# Autodesk Inventor assembly: BG_Gesammt
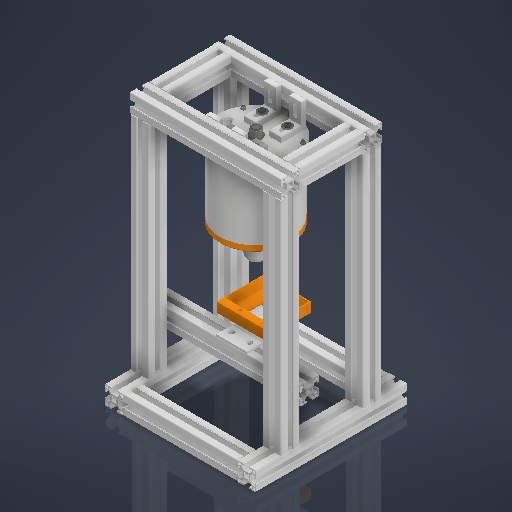
[picture p0: Inventor's stored thumbnail of the model, 512x512]
Saved by Autodesk Inventor 2027.1 (Build 311270010, 270A)
## iProperties
Created: 2026-10-16
Part Number: BG_Gesammt
Document SubType Name: Assembly
Designer: nicol
Author: nicol
## Documents named in this file (14)
- C:\Worksspace2\PA_2026\Electromagnetic_Levitation_System_git\Electromagnetic_Levitation_System\04_3D_Design\BG_Gesammt.iam
- C:\Worksspace2\PA_2026\Electromagnetic_Levitation_System_git\Electromagnetic_Levitation_System\04_3D_Design\Topfkern\BG_Topfkern.iam
- C:\Worksspace2\PA_2026\Electromagnetic_Levitation_System_git\Electromagnetic_Levitation_System\04_3D_Design\Sensor\OADM_13U6475_S35A\OADM_13U6475_S35A.ipt
- C:\Worksspace2\PA_2026\Electromagnetic_Levitation_System_git\Electromagnetic_Levitation_System\04_3D_Design\Schwebeobjekt\Kugel_30mm.ipt
- C:\Worksspace2\PA_2026\Electromagnetic_Levitation_System_git\Electromagnetic_Levitation_System\04_3D_Design\Gerüst\Befestigungswinkel 40 x 40 mit Langloch, schwarz.ipt
- C:\Users\nicol\OneDrive\Dokumente\Inventor\Content Center Files\R2027\en-US\ISO 7380-1\ISO 7380-1 - M5 x 16.ipt
- C:\Users\nicol\OneDrive\Dokumente\Inventor\Content Center Files\R2027\en-US\DIN EN ISO 7093-1\DIN EN ISO 7093-1 - 5.ipt
- C:\Worksspace2\PA_2026\Electromagnetic_Levitation_System_git\Electromagnetic_Levitation_System\04_3D_Design\Sensor\Sensor_Befestigung.ipt
- C:\Worksspace2\PA_2026\Electromagnetic_Levitation_System_git\Electromagnetic_Levitation_System\04_3D_Design\Sensor\Plexiglas.ipt
- C:\Worksspace2\PA_2026\Electromagnetic_Levitation_System_git\Electromagnetic_Levitation_System\04_3D_Design\Gerüst\Geruest_mit_30x30.iam
- C:\Worksspace2\PA_2026\Electromagnetic_Levitation_System_git\Electromagnetic_Levitation_System\04_3D_Design\Sensor\Kugelauffang.ipt
- C:\Worksspace2\PA_2026\Electromagnetic_Levitation_System_git\Electromagnetic_Levitation_System\04_3D_Design\Topfkern\Drahthalteplatte.ipt
- C:\Users\nicol\OneDrive\Dokumente\Inventor\Content Center Files\R2027\en-US\ISO 7380-1\ISO 7380-1 - M4 x 10.ipt
- C:\Users\nicol\OneDrive\Dokumente\Inventor\Content Center Files\R2027\en-US\ISO 7089\ISO 7089 - 4 - 140 HV(1).ipt
## Components (22 placed, 13 different names)
1. BG_Topfkern:1 [sub-assembly] — Mate:15, Mate:16, Mate:19, Mate:23, Mate:25, Mate:28, Mate:29, Mate:47, Mate:50, Mate:55, Mate:71, Mate:72
2. OADM_13U6475_S35A:1 — Mate:63, Flush:42, Flush:43, Flush:44
3. Kugel_30mm:1 — Mate:15, Mate:16
4. Befestigungswinkel 40 x 40 mit Langloch, schwarz:1 — Mate:19, Mate:24, Mate:53, Mate:61
5. Befestigungswinkel 40 x 40 mit Langloch, schwarz:2 — Mate:27, Mate:50, Mate:51, Mate:59
6. Befestigungswinkel 40 x 40 mit Langloch, schwarz:3 — Mate:22, Mate:55, Mate:56, Mate:60
7. ISO 7380-1 M5 x 16:1 — Mate:32, Mate:33, Mate:56
8. Befestigungswinkel 40 x 40 mit Langloch, schwarz:4 — Mate:26, Mate:47, Mate:48, Mate:57, Flush:39, Mate:58
9. ISO 7380-1 M5 x 16:2 — Mate:34, Mate:36, Mate:51
10. ISO 7380-1 M5 x 16:3 — Mate:35, Mate:37, Mate:48
11. ISO 7380-1 M5 x 16:4 — Mate:30, Mate:31, Mate:53
12. DIN EN ISO 7093-1 5:1 — Mate:24, Mate:25, Mate:30, Mate:31
13. DIN EN ISO 7093-1 5:2 — Mate:22, Mate:23, Mate:32, Mate:33
14. DIN EN ISO 7093-1 5:3 — Mate:27, Mate:29, Mate:34, Mate:36
15. DIN EN ISO 7093-1 5:4 — Mate:26, Mate:28, Mate:35, Mate:37
16. Sensor_Befestigung:1 — Flush:41, Mate:62, Flush:43, Mate:65, Mate:66, Mate:67
17. Plexiglas:1 — Mate:65, Mate:66, Mate:67, Mate:68, Mate:69, Mate:70
18. Geruest_mit_30x30:1 [sub-assembly] — Mate:57, Flush:39, Mate:58, Mate:59, Mate:60, Mate:61, Flush:41, Mate:62, Mate:63, Flush:42, Flush:44
19. Kugelauffang:1 — Mate:68, Mate:69, Mate:70
20. Drahthalteplatte:1 — Mate:71, Mate:72, Mate:73, Mate:74, Mate:75
21. ISO 7380-1 M4 x 10:1 — Mate:75, Mate:76
22. ISO 7089 4:1 — Mate:73, Mate:74, Mate:76
## Relationships (50: Mate 45, Flush 5)
- Mate:15: BG_Topfkern:1 ↔ Kugel_30mm:1
- Mate:16 (45 mm): BG_Topfkern:1 ↔ Kugel_30mm:1
- Mate:19: BG_Topfkern:1 ↔ Befestigungswinkel 40 x 40 mit Langloch, schwarz:1
- Mate:22: Befestigungswinkel 40 x 40 mit Langloch, schwarz:3 ↔ DIN EN ISO 7093-1 5:2
- Mate:23: BG_Topfkern:1 ↔ DIN EN ISO 7093-1 5:2
- Mate:24: Befestigungswinkel 40 x 40 mit Langloch, schwarz:1 ↔ DIN EN ISO 7093-1 5:1
- Mate:25: BG_Topfkern:1 ↔ DIN EN ISO 7093-1 5:1
- Mate:26: Befestigungswinkel 40 x 40 mit Langloch, schwarz:4 ↔ DIN EN ISO 7093-1 5:4
- Mate:27: Befestigungswinkel 40 x 40 mit Langloch, schwarz:2 ↔ DIN EN ISO 7093-1 5:3
- Mate:28: BG_Topfkern:1 ↔ DIN EN ISO 7093-1 5:4
- Mate:29: BG_Topfkern:1 ↔ DIN EN ISO 7093-1 5:3
- Mate:30: ISO 7380-1 M5 x 16:4 ↔ DIN EN ISO 7093-1 5:1
- Mate:31: ISO 7380-1 M5 x 16:4 ↔ DIN EN ISO 7093-1 5:1
- Mate:32: ISO 7380-1 M5 x 16:1 ↔ DIN EN ISO 7093-1 5:2
- Mate:33: ISO 7380-1 M5 x 16:1 ↔ DIN EN ISO 7093-1 5:2
- Mate:34: ISO 7380-1 M5 x 16:2 ↔ DIN EN ISO 7093-1 5:3
- Mate:35: ISO 7380-1 M5 x 16:3 ↔ DIN EN ISO 7093-1 5:4
- Mate:36: ISO 7380-1 M5 x 16:2 ↔ DIN EN ISO 7093-1 5:3
- Mate:37: ISO 7380-1 M5 x 16:3 ↔ DIN EN ISO 7093-1 5:4
- Mate:47: BG_Topfkern:1 ↔ Befestigungswinkel 40 x 40 mit Langloch, schwarz:4
- Mate:48 (3.05 mm): Befestigungswinkel 40 x 40 mit Langloch, schwarz:4 ↔ ISO 7380-1 M5 x 16:3
- Mate:50: BG_Topfkern:1 ↔ Befestigungswinkel 40 x 40 mit Langloch, schwarz:2
- Mate:51 (3.05 mm): Befestigungswinkel 40 x 40 mit Langloch, schwarz:2 ↔ ISO 7380-1 M5 x 16:2
- Mate:53 (3.05 mm): Befestigungswinkel 40 x 40 mit Langloch, schwarz:1 ↔ ISO 7380-1 M5 x 16:4
- Mate:55: BG_Topfkern:1 ↔ Befestigungswinkel 40 x 40 mit Langloch, schwarz:3
- Mate:56 (3.05 mm): Befestigungswinkel 40 x 40 mit Langloch, schwarz:3 ↔ ISO 7380-1 M5 x 16:1
- Mate:57: Befestigungswinkel 40 x 40 mit Langloch, schwarz:4 ↔ Geruest_mit_30x30:1
- Flush:39: Befestigungswinkel 40 x 40 mit Langloch, schwarz:4 ↔ Geruest_mit_30x30:1
- Mate:58 (60 mm): Befestigungswinkel 40 x 40 mit Langloch, schwarz:4 ↔ Geruest_mit_30x30:1
- Mate:59: Befestigungswinkel 40 x 40 mit Langloch, schwarz:2 ↔ Geruest_mit_30x30:1
- Mate:60: Befestigungswinkel 40 x 40 mit Langloch, schwarz:3 ↔ Geruest_mit_30x30:1
- Mate:61: Befestigungswinkel 40 x 40 mit Langloch, schwarz:1 ↔ Geruest_mit_30x30:1
- Flush:41: Sensor_Befestigung:1 ↔ Geruest_mit_30x30:1
- Mate:62: Sensor_Befestigung:1 ↔ Geruest_mit_30x30:1
- Mate:63 (83.5 mm): OADM_13U6475_S35A:1 ↔ Geruest_mit_30x30:1
- Flush:42: OADM_13U6475_S35A:1 ↔ Geruest_mit_30x30:1
- Flush:43: OADM_13U6475_S35A:1 ↔ Sensor_Befestigung:1
- Mate:65: Sensor_Befestigung:1 ↔ Plexiglas:1
- Mate:66: Sensor_Befestigung:1 ↔ Plexiglas:1
- Mate:67: Sensor_Befestigung:1 ↔ Plexiglas:1
- Mate:68: Plexiglas:1 ↔ Kugelauffang:1
- Mate:69: Plexiglas:1 ↔ Kugelauffang:1
- Mate:70: Plexiglas:1 ↔ Kugelauffang:1
- Flush:44 (-103 mm): OADM_13U6475_S35A:1 ↔ Geruest_mit_30x30:1
- Mate:71: BG_Topfkern:1 ↔ Drahthalteplatte:1
- Mate:72: BG_Topfkern:1 ↔ Drahthalteplatte:1
- Mate:73: Drahthalteplatte:1 ↔ ISO 7089 4:1
- Mate:74: Drahthalteplatte:1 ↔ ISO 7089 4:1
- Mate:75: Drahthalteplatte:1 ↔ ISO 7380-1 M4 x 10:1
- Mate:76: ISO 7380-1 M4 x 10:1 ↔ ISO 7089 4:1
